# Autodesk Inventor assembly: 6 DOF Manipulator arm
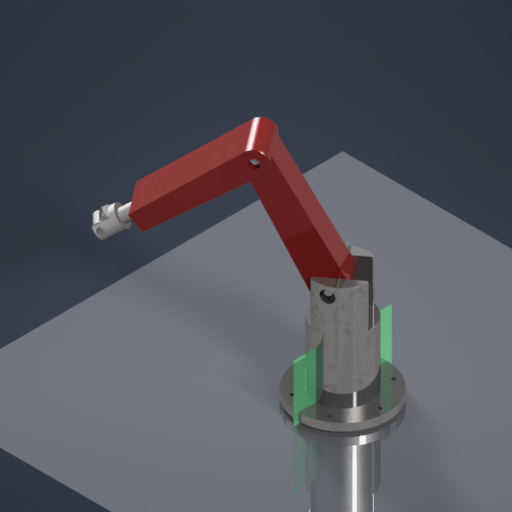
[picture p0: Inventor's stored thumbnail of the model, 512x512]
Saved by Autodesk Inventor 2026.2 (Build 302298000, 298)
## iProperties
Created: 2026-03-24
Part Number: 6 DOF Manipulator arm
Document SubType Name: Assembly
Designer: devna
Author: devna
## Documents named in this file (12)
- C:\Users\devna\OneDrive\Documents\6 DOF Manipulator arm.iam
- C:\Users\devna\OneDrive\Documents\Base_Link_0.ipt
- C:\Users\devna\OneDrive\Documents\Waist_Link_1.ipt
- C:\Users\devna\OneDrive\Documents\Shoulder_Link_2.ipt
- C:\Users\devna\OneDrive\Documents\Forearm_Link_3.ipt
- C:\Users\devna\OneDrive\Documents\Wrist_Housing_Link_4.ipt
- C:\Users\devna\OneDrive\Documents\Wrist_Pitch_Link_5.ipt
- C:\Users\devna\OneDrive\Documents\Tool_Flange_Link_6.ipt
- C:\Users\devna\OneDrive\Documents\Bearing_40x20.ipt
- C:\Users\devna\OneDrive\Documents\Shaft_20mm.ipt
- C:\Users\devna\OneDrive\Documents\Bearing_30x15.ipt
- C:\Users\devna\OneDrive\Documents\Shaft_15mm.ipt
## Components (13 placed, 11 different names)
1. Base_Link_0:1 — Rotational:1
2. Waist_Link_1:1 — Rotational:1, Insert:6, Insert:7, Insert:8
3. Shoulder_Link_2:1 — Insert:2, Mate:1, Flush:1, Mate:2
4. Forearm_Link_3:1 — Insert:2, Insert:9, Insert:10, Mate:2, Flush:2, Insert:12
5. Wrist_Housing_Link_4:1 — Insert:4, Insert:12
6. Wrist_Pitch_Link_5:1 — Insert:4, Insert:5
7. Tool_Flange_Link_6:1 — Insert:5
8. Bearing_40x20:1 — Insert:7, Flush:1
9. Shaft_20mm:1 — Mate:1, Insert:8
10. Bearing_40x20:2 — Insert:6
11. Bearing_30x15:1 — Insert:9
12. Bearing_30x15:2 — Insert:10, Flush:2, Insert:11
13. Shaft_15mm:1 — Insert:11
## Relationships (15: Insert 10, Mate 2, Flush 2, RevoluteJoint 1)
- Rotational:1 [RevoluteJoint]: Base_Link_0:1 ↔ Waist_Link_1:1
- Insert:2 (1 mm): Shoulder_Link_2:1 ↔ Forearm_Link_3:1
- Insert:4 (1 mm): Wrist_Housing_Link_4:1 ↔ Wrist_Pitch_Link_5:1
- Insert:5: Wrist_Pitch_Link_5:1 ↔ Tool_Flange_Link_6:1
- Insert:6: Waist_Link_1:1 ↔ Bearing_40x20:2
- Insert:7: Waist_Link_1:1 ↔ Bearing_40x20:1
- Mate:1: Shoulder_Link_2:1 ↔ Shaft_20mm:1
- Flush:1 (-1.05 mm): Shoulder_Link_2:1 ↔ Bearing_40x20:1
- Insert:8 (-20 mm): Waist_Link_1:1 ↔ Shaft_20mm:1
- Insert:9: Forearm_Link_3:1 ↔ Bearing_30x15:1
- Insert:10: Forearm_Link_3:1 ↔ Bearing_30x15:2
- Mate:2: Shoulder_Link_2:1 ↔ Forearm_Link_3:1
- Flush:2 (-20 mm): Forearm_Link_3:1 ↔ Bearing_30x15:2
- Insert:11 (-110 mm): Bearing_30x15:2 ↔ Shaft_15mm:1
- Insert:12: Forearm_Link_3:1 ↔ Wrist_Housing_Link_4:1
